# Autodesk Inventor assembly: as_angle
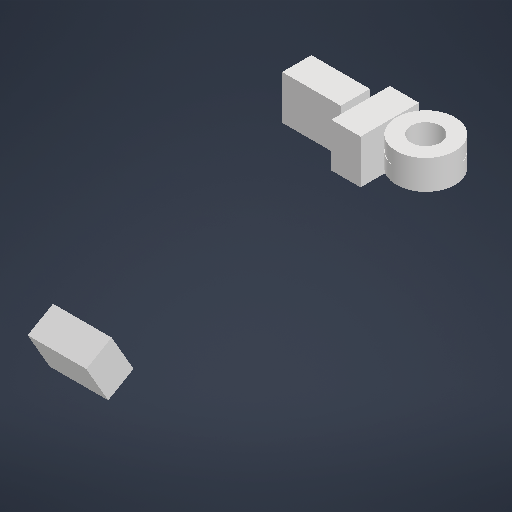
[picture p0: Inventor's stored thumbnail of the model, 512x512]
Saved by Autodesk Inventor 2027 (Build 310192060, 192F)
## iProperties
Created: 2026-10-20
Part Number: as_angle
Document SubType Name: Assembly
Designer: vmiguel
Author: vmiguel
## Documents named in this file (3)
- C:\Users\vmiguel\git\inventor-interface\writer\fixtures\spec\as_angle.iam
- C:\Users\vmiguel\git\inventor-interface\writer\fixtures\spec\ex_rect20.ipt
- C:\Users\vmiguel\git\inventor-interface\writer\fixtures\spec\rv_full.ipt
## Components (5 placed, 2 different names)
1. ex_rect20:1 — Mate:1, Flush:1, Angle:1
2. ex_rect20:2 — Mate:1, Flush:1, Tangent:1
3. rv_full:1 — Insert:1, Tangent:1
4. rv_full:2 — Insert:1
5. ex_rect20:3 — Angle:1
## Relationships (5: Mate 1, Flush 1, Insert 1, Tangent 1, Angle 1)
- Mate:1 (5 mm): ex_rect20:1 ↔ ex_rect20:2
- Flush:1: ex_rect20:1 ↔ ex_rect20:2
- Insert:1: rv_full:1 ↔ rv_full:2
- Tangent:1: ex_rect20:2 ↔ rv_full:1
- Angle:1 (30 deg): ex_rect20:1 ↔ ex_rect20:3
